# Autodesk Inventor assembly: mano_VF
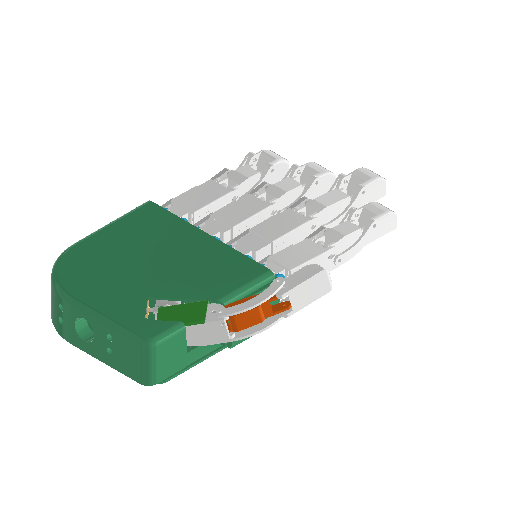
[picture p0: Inventor's stored thumbnail of the model, 512x512]
Saved by Autodesk Inventor 2026 (Build 300175050, 175E)
## iProperties
Created: 2026-04-25
Part Number: mano_VF
Document SubType Name: Assembly
Designer: thepr
Author: thepr
## Documents named in this file (36)
- C:\Users\thepr\OneDrive\Escritorio\Memoria\Version_final\mano_VF.iam
- C:\Users\thepr\OneDrive\Escritorio\preprosthetic-robotic-hand\cad\native\Palma.ipt
- C:\Users\thepr\OneDrive\Escritorio\Memoria\Version_final\pulgar_VF\Prox_pulgar.ipt
- C:\Users\thepr\OneDrive\Escritorio\Memoria\Version_final\pulgar_VF\Tierra_pulgar.ipt
- C:\Users\thepr\OneDrive\Escritorio\Memoria\Version_final\pulgar_VF\Diag_pulgar.ipt
- C:\Users\thepr\OneDrive\Escritorio\Memoria\Version_final\pulgar_VF\distal_pulgar.ipt
- C:\Users\thepr\OneDrive\Escritorio\Memoria\Version_final\pulgar_VF\tapa_pulgar.ipt
- C:\Users\thepr\OneDrive\Escritorio\Memoria\Version_final\menique_VF\Meta_menique.ipt
- C:\Users\thepr\OneDrive\Escritorio\Memoria\Version_final\menique_VF\Prox_menique.ipt
- C:\Users\thepr\OneDrive\Escritorio\Memoria\Version_final\menique_VF\Tierra_menique.ipt
- C:\Users\thepr\OneDrive\Escritorio\Memoria\Version_final\menique_VF\Diag_menique.ipt
- C:\Users\thepr\OneDrive\Escritorio\Memoria\Version_final\menique_VF\distal_menique.ipt
- C:\Users\thepr\OneDrive\Escritorio\Memoria\DEDO_final\Tapa_meta_indice.ipt
- C:\Users\thepr\OneDrive\Escritorio\Memoria\Version_final\anular_VF\Meta_anular.ipt
- C:\Users\thepr\OneDrive\Escritorio\Memoria\Version_final\anular_VF\Prox_Indice.ipt
- C:\Users\thepr\OneDrive\Escritorio\Memoria\Version_final\medio_VF\Tapa_prox_medio.ipt
- C:\Users\thepr\OneDrive\Escritorio\Memoria\Version_final\anular_VF\Tierra_Indice.ipt
- C:\Users\thepr\OneDrive\Escritorio\Memoria\Version_final\anular_VF\Diag_Indice.ipt
- C:\Users\thepr\OneDrive\Escritorio\Memoria\Version_final\anular_VF\distal_indice.ipt
- C:\Users\thepr\OneDrive\Escritorio\Memoria\Version_final\medio_VF\Meta_medio.ipt
- C:\Users\thepr\OneDrive\Escritorio\Memoria\Version_final\medio_VF\Prox_medio.ipt
- C:\Users\thepr\OneDrive\Escritorio\Memoria\Version_final\medio_VF\Tierra_medio.ipt
- C:\Users\thepr\OneDrive\Escritorio\Memoria\Version_final\medio_VF\Diag_medio.ipt
- C:\Users\thepr\OneDrive\Escritorio\Memoria\Version_final\medio_VF\distal_medio.ipt
- C:\Users\thepr\OneDrive\Escritorio\Memoria\Dedos\Meta_indice.ipt
- C:\Users\thepr\OneDrive\Escritorio\Memoria\Dedos\Anular\segunda_anular2.ipt
- C:\Users\thepr\OneDrive\Escritorio\Memoria\Dedos\Anular\Diag_Anular.ipt
- C:\Users\thepr\OneDrive\Escritorio\Memoria\Version_final\indice_VF\Prox_anularVF2.ipt
- C:\Users\thepr\OneDrive\Escritorio\preprosthetic-robotic-hand\cad\native\Cubre_palma.ipt
- C:\Users\thepr\OneDrive\Escritorio\Memoria\Version_final\sabado\tapa_pulgar_PIP.ipt
- C:\Users\thepr\Downloads\n20-mini-micro-metal-gear-motor-with-encoder-1.snapshot.2\N20 Mini Micro Metall Gear Motor DC 3-6-12V v1.ipt
- C:\Users\thepr\OneDrive\Escritorio\Memoria\DEDO_final\engranes.iam
- C:\Users\thepr\OneDrive\Escritorio\Memoria\Version_final\indice_VF\transmision_motor.ipt
- C:\Users\thepr\OneDrive\Escritorio\Memoria\Version_final\indice_VF\tuerca.ipt
- C:\Users\thepr\OneDrive\Escritorio\Memoria\Version_final\indice_VF\transmision_motor_medio.ipt
- C:\Users\thepr\OneDrive\Escritorio\Memoria\Version_final\indice_VF\transmision_motor_anular.ipt
## Components (75 placed, 35 different names)
1. Palma:1 — ABD_menique, ABD_anular, ABD_medio, Coincidencia:15, De rotación:39, Coincidencia:23, De rotación:41, Coincidencia:27, Coincidencia:28, Coincidencia:37, Coincidencia:41, Coincidencia:81, Coincidencia:82, Coincidencia:83, Coincidencia:110, Coincidencia:111, Coincidencia:112
2. Prox_pulgar:1 — Coincidencia:25, Coincidencia:26, De rotación:41, De rotación:42, Coincidencia:76, Coincidencia:77, Coincidencia:78, Coincidencia:84
3. Tierra_pulgar:1 — De rotación:42, Coincidencia:79, Coincidencia:104, Coincidencia:105, Coincidencia:106
4. Diag_pulgar:1
5. distal_pulgar:1
6. Diag_pulgar:2
7. tapa_pulgar:1 — Coincidencia:25, Coincidencia:26
8. Meta_menique:1 — MCP_menique, ABD_menique, Coincidencia:42, Coincidencia:43, Coincidencia:44
9. Prox_menique:1 — MCP_menique, Coincidencia:50, Coincidencia:69, Coincidencia:70, Coincidencia:71, Coincidencia:72, Coincidencia:73, Coincidencia:74, De rotación:46, Coincidencia:96
10. Tierra_menique:1 — De rotación:46, Coincidencia:91, Coincidencia:93, Coincidencia:94
11. Diag_menique:1
12. distal_menique:1
13. Diag_menique:2
14. Tapa_meta_indice:1 — Coincidencia:41
15. Meta_anular:1 — MCP_anular, ABD_anular, Coincidencia:38, Coincidencia:39, Coincidencia:40
16. Tapa_meta_indice:2 — Coincidencia:37
17. Prox_Indice:1 — MCP_anular, Coincidencia:48, Coincidencia:63, Coincidencia:64, Coincidencia:65, Coincidencia:66, Coincidencia:67, De rotación:45, Coincidencia:109
18. Tapa_prox_medio:1 — Coincidencia:63
19. Tierra_Indice:1 — De rotación:45, Coincidencia:92, Coincidencia:100, Coincidencia:101
20. Diag_Indice:1
21. distal_indice:1
22. Diag_Indice:2
23. Meta_medio:1 — MCP_medio, ABD_medio, Coincidencia:34, Coincidencia:35, Coincidencia:36
24. Prox_medio:1 — MCP_medio, Coincidencia:46, Coincidencia:57, Coincidencia:58, Coincidencia:59, Coincidencia:60, De rotación:43, Coincidencia:108
25. Tierra_medio:1 — De rotación:43, Coincidencia:61, De rotación:44, Coincidencia:97, Coincidencia:98, Coincidencia:99
26. Diag_medio:1
27. distal_medio:1 — De rotación:44
28. Tapa_meta_indice:3 — Coincidencia:15
29. Tapa_prox_medio:2 — Coincidencia:57
30. Diag_medio:2
31. Meta_indice:1 — De rotación:39, De rotación:40, Coincidencia:31, Coincidencia:32, Coincidencia:33
32. segunda_anular2:1 — De rotación:47
33. Diag_Anular:1
34. Diag_Anular:2
35. Tapa_meta_indice:4 — Coincidencia:23
36. Prox_anularVF2:1 — De rotación:40, Coincidencia:24, Coincidencia:45, Coincidencia:52, Coincidencia:53, Coincidencia:54, De rotación:48, Coincidencia:86
37. Tierra_Indice:2 — Coincidencia:55, De rotación:47, De rotación:48, Coincidencia:87, Coincidencia:88, Coincidencia:89
38. Tapa_prox_medio:3 — Coincidencia:24
39. Cubre_palma:1 — Coincidencia:110, Coincidencia:111, Coincidencia:112
40. tapa_pulgar_PIP:1 — Coincidencia:27, Coincidencia:28
41. N20 Mini Micro Metall Gear Motor DC 3-6-12V v1:1 — Coincidencia:31, Coincidencia:32, Coincidencia:33, Cilíndrica:1
42. N20 Mini Micro Metall Gear Motor DC 3-6-12V v1:2 — Coincidencia:34, Coincidencia:35, Coincidencia:36, Coincidencia:47
43. N20 Mini Micro Metall Gear Motor DC 3-6-12V v1:3 — Coincidencia:38, Coincidencia:39, Coincidencia:40, Coincidencia:49
44. N20 Mini Micro Metall Gear Motor DC 3-6-12V v1:4 — Coincidencia:42, Coincidencia:43, Coincidencia:44, Coincidencia:51
45. engranes:1 [sub-assembly] — Coincidencia:45, Cilíndrica:1, De rotación:49
46. engranes:2 [sub-assembly] — Coincidencia:46, Coincidencia:47, De rotación:56
47. engranes:3 [sub-assembly] — Coincidencia:48, Coincidencia:49, De rotación:57
48. engranes:4 [sub-assembly] — Coincidencia:50, Coincidencia:51, De rotación:52
49. N20 Mini Micro Metall Gear Motor DC 3-6-12V v1:5 — Coincidencia:52, Coincidencia:53, Coincidencia:54, Coincidencia:56
50. engranes:5 [sub-assembly] — Coincidencia:55, Coincidencia:56, De rotación:50
51. N20 Mini Micro Metall Gear Motor DC 3-6-12V v1:6 — Coincidencia:58, Coincidencia:59, Coincidencia:60, Coincidencia:62
52. engranes:6 [sub-assembly] — Coincidencia:61, Coincidencia:62, De rotación:54
53. N20 Mini Micro Metall Gear Motor DC 3-6-12V v1:7 — Coincidencia:64, Coincidencia:65, Coincidencia:66, Coincidencia:68
54. engranes:7 [sub-assembly] — Coincidencia:67, Coincidencia:68, De rotación:53
55. Tapa_prox_medio:4 — Coincidencia:69, Coincidencia:70
56. N20 Mini Micro Metall Gear Motor DC 3-6-12V v1:8 — Coincidencia:71, Coincidencia:72, Coincidencia:73, Coincidencia:75
57. engranes:8 [sub-assembly] — Coincidencia:74, Coincidencia:75, De rotación:51
58. N20 Mini Micro Metall Gear Motor DC 3-6-12V v1:9 — Coincidencia:76, Coincidencia:77, Coincidencia:78, Coincidencia:80
59. engranes:9 [sub-assembly] — Coincidencia:79, Coincidencia:80, De rotación:55
60. N20 Mini Micro Metall Gear Motor DC 3-6-12V v1:10 — Coincidencia:81, Coincidencia:82, Coincidencia:83, Coincidencia:85
61. engranes:10 [sub-assembly] — Coincidencia:84, Coincidencia:85
62. transmision_motor:1 — De rotación:49, Coincidencia:86
63. transmision_motor:2 — De rotación:50, Coincidencia:90
64. tuerca:1 — Coincidencia:87, Coincidencia:88, Coincidencia:89, Coincidencia:90
65. tuerca:2 — Coincidencia:91, Coincidencia:93, Coincidencia:94, Coincidencia:95
66. tuerca:3 — Coincidencia:97, Coincidencia:98, Coincidencia:99, Coincidencia:103
67. tuerca:4 — Coincidencia:92, Coincidencia:100, Coincidencia:101, Coincidencia:102
68. transmision_motor:3 — De rotación:51, Coincidencia:95
69. transmision_motor:4 — De rotación:52, Coincidencia:96
70. transmision_motor:5 — De rotación:53, Coincidencia:102
71. transmision_motor:6 — De rotación:54, Coincidencia:103
72. transmision_motor:7 — De rotación:55, Coincidencia:107
73. tuerca:5 — Coincidencia:104, Coincidencia:105, Coincidencia:106, Coincidencia:107
74. transmision_motor_medio:1 — De rotación:56, Coincidencia:108
75. transmision_motor_anular:1 — De rotación:57, Coincidencia:109
## Relationships (149: Mate 100, RevoluteJoint 48, CylindricalJoint 1)
- [RevoluteJoint]: Tierra_pulgar:1 ↔ distal_pulgar:1
- [RevoluteJoint]: Diag_pulgar:1 ↔ distal_pulgar:1
- [RevoluteJoint]: distal_pulgar:1 ↔ Diag_pulgar:2
- [RevoluteJoint]: Prox_pulgar:1 ↔ Diag_pulgar:2
- [RevoluteJoint]: Prox_pulgar:1 ↔ Diag_pulgar:1
- [Mate]: Meta_menique:1 ↔ Tapa_meta_indice:1
- [Mate]: Meta_menique:1 ↔ Tapa_meta_indice:1
- MCP_menique [RevoluteJoint]: Meta_menique:1 ↔ Prox_menique:1
- [RevoluteJoint]: Prox_menique:1 ↔ Diag_menique:1
- [RevoluteJoint]: Prox_menique:1 ↔ Diag_menique:2
- [RevoluteJoint]: Tierra_menique:1 ↔ distal_menique:1
- [RevoluteJoint] (-0.2 mm): Diag_menique:1 ↔ distal_menique:1
- [RevoluteJoint] (0.2 mm): distal_menique:1 ↔ Diag_menique:2
- ABD_menique [RevoluteJoint]: Palma:1 ↔ Meta_menique:1
- [Mate]: Meta_anular:1 ↔ Tapa_meta_indice:2
- [Mate]: Meta_anular:1 ↔ Tapa_meta_indice:2
- [Mate]: Prox_Indice:1 ↔ Tapa_prox_medio:1
- MCP_anular [RevoluteJoint]: Meta_anular:1 ↔ Prox_Indice:1
- [RevoluteJoint]: Prox_Indice:1 ↔ Diag_Indice:1
- [RevoluteJoint]: Diag_Indice:1 ↔ distal_indice:1
- [RevoluteJoint]: Prox_Indice:1 ↔ Diag_Indice:2
- [RevoluteJoint]: Tierra_Indice:1 ↔ distal_indice:1
- [RevoluteJoint]: distal_indice:1 ↔ Diag_Indice:2
- ABD_anular [RevoluteJoint]: Palma:1 ↔ Meta_anular:1
- [Mate]: Meta_medio:1 ↔ Tapa_meta_indice:3
- [Mate]: Meta_medio:1 ↔ Tapa_meta_indice:3
- [Mate]: Prox_medio:1 ↔ Tapa_prox_medio:2
- MCP_medio [RevoluteJoint]: Meta_medio:1 ↔ Prox_medio:1
- [RevoluteJoint]: Prox_medio:1 ↔ Diag_medio:1
- [RevoluteJoint]: Diag_medio:1 ↔ distal_medio:1
- [RevoluteJoint]: Prox_medio:1 ↔ Diag_medio:2
- [RevoluteJoint]: distal_medio:1 ↔ Diag_medio:2
- ABD_medio [RevoluteJoint]: Palma:1 ↔ Meta_medio:1
- Coincidencia:15 [Mate]: Palma:1 ↔ Tapa_meta_indice:3
- [RevoluteJoint]: Diag_Anular:1 ↔ Prox_anularVF2:1
- [RevoluteJoint] (-0.2 mm): segunda_anular2:1 ↔ Diag_Anular:1
- [RevoluteJoint]: Diag_Anular:2 ↔ Prox_anularVF2:1
- [RevoluteJoint] (0.2 mm): segunda_anular2:1 ↔ Diag_Anular:2
- [Mate]: Meta_indice:1 ↔ Tapa_meta_indice:4
- [Mate]: Meta_indice:1 ↔ Tapa_meta_indice:4
- [Mate]: Prox_anularVF2:1 ↔ Tapa_prox_medio:3
- De rotación:39 [RevoluteJoint]: Palma:1 ↔ Meta_indice:1
- Coincidencia:23 [Mate] (0.1 mm): Palma:1 ↔ Tapa_meta_indice:4
- De rotación:40 [RevoluteJoint]: Meta_indice:1 ↔ Prox_anularVF2:1
- Coincidencia:24 [Mate]: Prox_anularVF2:1 ↔ Tapa_prox_medio:3
- Coincidencia:25 [Mate]: Prox_pulgar:1 ↔ tapa_pulgar:1
- Coincidencia:26 [Mate]: Prox_pulgar:1 ↔ tapa_pulgar:1
- De rotación:41 [RevoluteJoint]: Palma:1 ↔ Prox_pulgar:1
- De rotación:42 [RevoluteJoint] (-0.2 mm): Prox_pulgar:1 ↔ Tierra_pulgar:1
- Coincidencia:27 [Mate]: Palma:1 ↔ tapa_pulgar_PIP:1
- Coincidencia:28 [Mate]: Palma:1 ↔ tapa_pulgar_PIP:1
- Coincidencia:31 [Mate]: Meta_indice:1 ↔ N20 Mini Micro Metall Gear Motor DC 3-6-12V v1:1
- Coincidencia:32 [Mate]: Meta_indice:1 ↔ N20 Mini Micro Metall Gear Motor DC 3-6-12V v1:1
- Coincidencia:33 [Mate]: Meta_indice:1 ↔ N20 Mini Micro Metall Gear Motor DC 3-6-12V v1:1
- Coincidencia:34 [Mate]: Meta_medio:1 ↔ N20 Mini Micro Metall Gear Motor DC 3-6-12V v1:2
- Coincidencia:35 [Mate]: Meta_medio:1 ↔ N20 Mini Micro Metall Gear Motor DC 3-6-12V v1:2
- Coincidencia:36 [Mate]: Meta_medio:1 ↔ N20 Mini Micro Metall Gear Motor DC 3-6-12V v1:2
- Coincidencia:37 [Mate]: Palma:1 ↔ Tapa_meta_indice:2
- Coincidencia:38 [Mate]: Meta_anular:1 ↔ N20 Mini Micro Metall Gear Motor DC 3-6-12V v1:3
- Coincidencia:39 [Mate]: Meta_anular:1 ↔ N20 Mini Micro Metall Gear Motor DC 3-6-12V v1:3
- Coincidencia:40 [Mate]: Meta_anular:1 ↔ N20 Mini Micro Metall Gear Motor DC 3-6-12V v1:3
- Coincidencia:41 [Mate]: Palma:1 ↔ Tapa_meta_indice:1
- Coincidencia:42 [Mate]: Meta_menique:1 ↔ N20 Mini Micro Metall Gear Motor DC 3-6-12V v1:4
- Coincidencia:43 [Mate]: Meta_menique:1 ↔ N20 Mini Micro Metall Gear Motor DC 3-6-12V v1:4
- Coincidencia:44 [Mate]: Meta_menique:1 ↔ N20 Mini Micro Metall Gear Motor DC 3-6-12V v1:4
- Coincidencia:45 [Mate]: Prox_anularVF2:1 ↔ engranes:1
- Cilíndrica:1 [CylindricalJoint]: N20 Mini Micro Metall Gear Motor DC 3-6-12V v1:1 ↔ engranes:1
- Coincidencia:46 [Mate]: Prox_medio:1 ↔ engranes:2
- Coincidencia:47 [Mate]: N20 Mini Micro Metall Gear Motor DC 3-6-12V v1:2 ↔ engranes:2
- Coincidencia:48 [Mate]: Prox_Indice:1 ↔ engranes:3
- Coincidencia:49 [Mate]: N20 Mini Micro Metall Gear Motor DC 3-6-12V v1:3 ↔ engranes:3
- Coincidencia:50 [Mate]: Prox_menique:1 ↔ engranes:4
- Coincidencia:51 [Mate]: N20 Mini Micro Metall Gear Motor DC 3-6-12V v1:4 ↔ engranes:4
- Coincidencia:52 [Mate]: Prox_anularVF2:1 ↔ N20 Mini Micro Metall Gear Motor DC 3-6-12V v1:5
- Coincidencia:53 [Mate]: Prox_anularVF2:1 ↔ N20 Mini Micro Metall Gear Motor DC 3-6-12V v1:5
- Coincidencia:54 [Mate]: Prox_anularVF2:1 ↔ N20 Mini Micro Metall Gear Motor DC 3-6-12V v1:5
- Coincidencia:55 [Mate]: Tierra_Indice:2 ↔ engranes:5
- Coincidencia:56 [Mate]: N20 Mini Micro Metall Gear Motor DC 3-6-12V v1:5 ↔ engranes:5
- Coincidencia:57 [Mate]: Prox_medio:1 ↔ Tapa_prox_medio:2
- Coincidencia:58 [Mate]: Prox_medio:1 ↔ N20 Mini Micro Metall Gear Motor DC 3-6-12V v1:6
- Coincidencia:59 [Mate]: Prox_medio:1 ↔ N20 Mini Micro Metall Gear Motor DC 3-6-12V v1:6
- Coincidencia:60 [Mate]: Prox_medio:1 ↔ N20 Mini Micro Metall Gear Motor DC 3-6-12V v1:6
- De rotación:43 [RevoluteJoint]: Prox_medio:1 ↔ Tierra_medio:1
- Coincidencia:61 [Mate]: Tierra_medio:1 ↔ engranes:6
- Coincidencia:62 [Mate]: N20 Mini Micro Metall Gear Motor DC 3-6-12V v1:6 ↔ engranes:6
- De rotación:44 [RevoluteJoint] (-0.2 mm): Tierra_medio:1 ↔ distal_medio:1
- Coincidencia:63 [Mate]: Prox_Indice:1 ↔ Tapa_prox_medio:1
- Coincidencia:64 [Mate]: Prox_Indice:1 ↔ N20 Mini Micro Metall Gear Motor DC 3-6-12V v1:7
- Coincidencia:65 [Mate]: Prox_Indice:1 ↔ N20 Mini Micro Metall Gear Motor DC 3-6-12V v1:7
- Coincidencia:66 [Mate]: Prox_Indice:1 ↔ N20 Mini Micro Metall Gear Motor DC 3-6-12V v1:7
- Coincidencia:67 [Mate]: Prox_Indice:1 ↔ engranes:7
- Coincidencia:68 [Mate]: N20 Mini Micro Metall Gear Motor DC 3-6-12V v1:7 ↔ engranes:7
- De rotación:45 [RevoluteJoint] (0.1 mm): Prox_Indice:1 ↔ Tierra_Indice:1
- Coincidencia:69 [Mate]: Prox_menique:1 ↔ Tapa_prox_medio:4
- Coincidencia:70 [Mate]: Prox_menique:1 ↔ Tapa_prox_medio:4
- Coincidencia:71 [Mate]: Prox_menique:1 ↔ N20 Mini Micro Metall Gear Motor DC 3-6-12V v1:8
- Coincidencia:72 [Mate]: Prox_menique:1 ↔ N20 Mini Micro Metall Gear Motor DC 3-6-12V v1:8
- Coincidencia:73 [Mate]: Prox_menique:1 ↔ N20 Mini Micro Metall Gear Motor DC 3-6-12V v1:8
- Coincidencia:74 [Mate]: Prox_menique:1 ↔ engranes:8
- Coincidencia:75 [Mate]: N20 Mini Micro Metall Gear Motor DC 3-6-12V v1:8 ↔ engranes:8
- De rotación:46 [RevoluteJoint] (0.3 mm): Prox_menique:1 ↔ Tierra_menique:1
- De rotación:47 [RevoluteJoint]: segunda_anular2:1 ↔ Tierra_Indice:2
- De rotación:48 [RevoluteJoint] (0.3 mm): Prox_anularVF2:1 ↔ Tierra_Indice:2
- Coincidencia:76 [Mate]: Prox_pulgar:1 ↔ N20 Mini Micro Metall Gear Motor DC 3-6-12V v1:9
- Coincidencia:77 [Mate]: Prox_pulgar:1 ↔ N20 Mini Micro Metall Gear Motor DC 3-6-12V v1:9
- Coincidencia:78 [Mate]: Prox_pulgar:1 ↔ N20 Mini Micro Metall Gear Motor DC 3-6-12V v1:9
- Coincidencia:79 [Mate]: Tierra_pulgar:1 ↔ engranes:9
- Coincidencia:80 [Mate]: N20 Mini Micro Metall Gear Motor DC 3-6-12V v1:9 ↔ engranes:9
- Coincidencia:81 [Mate]: Palma:1 ↔ N20 Mini Micro Metall Gear Motor DC 3-6-12V v1:10
- Coincidencia:82 [Mate]: Palma:1 ↔ N20 Mini Micro Metall Gear Motor DC 3-6-12V v1:10
- Coincidencia:83 [Mate]: Palma:1 ↔ N20 Mini Micro Metall Gear Motor DC 3-6-12V v1:10
- Coincidencia:84 [Mate]: Prox_pulgar:1 ↔ engranes:10
- Coincidencia:85 [Mate]: N20 Mini Micro Metall Gear Motor DC 3-6-12V v1:10 ↔ engranes:10
- De rotación:49 [RevoluteJoint]: engranes:1 ↔ transmision_motor:1
- Coincidencia:86 [Mate] (1.7 mm): Prox_anularVF2:1 ↔ transmision_motor:1
- De rotación:50 [RevoluteJoint]: engranes:5 ↔ transmision_motor:2
- Coincidencia:87 [Mate]: Tierra_Indice:2 ↔ tuerca:1
- Coincidencia:88 [Mate]: Tierra_Indice:2 ↔ tuerca:1
- Coincidencia:89 [Mate]: Tierra_Indice:2 ↔ tuerca:1
- Coincidencia:90 [Mate] (3 mm): transmision_motor:2 ↔ tuerca:1
- Coincidencia:91 [Mate]: Tierra_menique:1 ↔ tuerca:2
- Coincidencia:92 [Mate]: Tierra_Indice:1 ↔ tuerca:4
- Coincidencia:93 [Mate]: Tierra_menique:1 ↔ tuerca:2
- Coincidencia:94 [Mate]: Tierra_menique:1 ↔ tuerca:2
- De rotación:51 [RevoluteJoint]: engranes:8 ↔ transmision_motor:3
- Coincidencia:95 [Mate] (3 mm): tuerca:2 ↔ transmision_motor:3
- De rotación:52 [RevoluteJoint]: engranes:4 ↔ transmision_motor:4
- Coincidencia:96 [Mate] (0.9 mm): Prox_menique:1 ↔ transmision_motor:4
- Coincidencia:97 [Mate]: Tierra_medio:1 ↔ tuerca:3
- Coincidencia:98 [Mate]: Tierra_medio:1 ↔ tuerca:3
- Coincidencia:99 [Mate]: Tierra_medio:1 ↔ tuerca:3
- Coincidencia:100 [Mate]: Tierra_Indice:1 ↔ tuerca:4
- Coincidencia:101 [Mate]: Tierra_Indice:1 ↔ tuerca:4
- De rotación:53 [RevoluteJoint]: engranes:7 ↔ transmision_motor:5
- Coincidencia:102 [Mate] (3 mm): tuerca:4 ↔ transmision_motor:5
- De rotación:54 [RevoluteJoint]: engranes:6 ↔ transmision_motor:6
- Coincidencia:103 [Mate] (3 mm): tuerca:3 ↔ transmision_motor:6
- De rotación:55 [RevoluteJoint]: engranes:9 ↔ transmision_motor:7
- Coincidencia:104 [Mate]: Tierra_pulgar:1 ↔ tuerca:5
- Coincidencia:105 [Mate]: Tierra_pulgar:1 ↔ tuerca:5
- Coincidencia:106 [Mate]: Tierra_pulgar:1 ↔ tuerca:5
- Coincidencia:107 [Mate] (3 mm): transmision_motor:7 ↔ tuerca:5
- De rotación:56 [RevoluteJoint]: engranes:2 ↔ transmision_motor_medio:1
- Coincidencia:108 [Mate] (0.9 mm): Prox_medio:1 ↔ transmision_motor_medio:1
- De rotación:57 [RevoluteJoint]: engranes:3 ↔ transmision_motor_anular:1
- Coincidencia:109 [Mate] (0.9 mm): Prox_Indice:1 ↔ transmision_motor_anular:1
- Coincidencia:110 [Mate]: Palma:1 ↔ Cubre_palma:1
- Coincidencia:111 [Mate]: Palma:1 ↔ Cubre_palma:1
- Coincidencia:112 [Mate]: Palma:1 ↔ Cubre_palma:1
## Named parameters: d32_d38 = 0.2 mm, d33_d39 = 37.828625 deg, d38_d30 = 0 mm, d39_d31 = 65.917889 deg, d52_d26 = 0 mm, d53_d27 = 107.952199 deg, d54_d30 = 0 mm, d55_d31 = -34.483949 deg, d58_d34 = 0 mm, d59_d35 = 56.716836 deg, d60_d36 = 0 mm, d61_d37 = 34.483949 deg, d65_d5 = 0 mm, d66_d22 = 0 mm, d67_d23 = 0 deg, d72_d34 = 0 mm, d73_d35 = -108.382123 deg, d74_d36 = 0 mm, d75_d37 = 42.848191 deg, d76_d10 = 0 mm, d77_d11 = 0 mm, d80_d22 = 0 mm, d81_d23 = 0 deg, d88_d32 = 0 mm, d89_d33 = -42.848191 deg
